# Autodesk Inventor assembly: MM0937AN100_G15_001
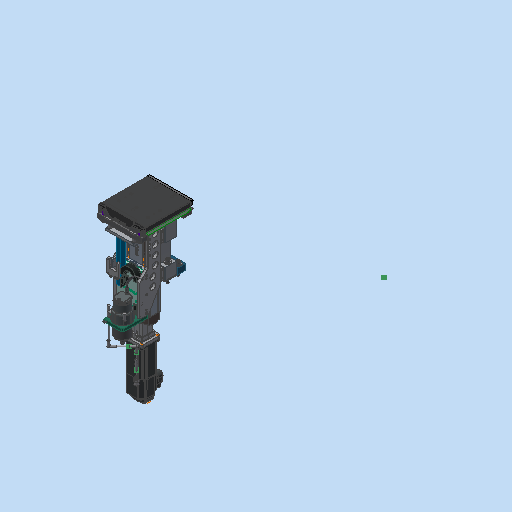
[picture p0: Inventor's stored thumbnail of the model, 512x512]
Saved by Autodesk Inventor 2023.3 (Build 273359000, 359)
## iProperties
RuleStatus: InUse
Created: 2020-12-03
Part Number: MM0937AN100_G15_001
Description: =<RBPARTNOTITLE2>
Document SubType Name: Assembly
Designer: RUD
Mass: 49756.3 g
Surface Area: 14216.7 cm^2
Volume: 7258.05 cm^3
Density: 6.85532 g/cm^3
AnP_Kategorie: 99
AnP_Material: =<Material>
AnP_TemplVers: 20200821
RBDOCUMENTTYPE: DRF
RBDOCUMENTVERSION: 00
RBDRAWINGMAINSCALE: 1:1
RBDRAWINGMISSINGSPEC: --
RBDRAWINGVOLUME: --
RBDSV1: 0850
RBGBEDGESIN1: +0,5
RBGBEDGESIN2: +0,2
RBGBEDGESOUT1: -0,3
RBGBEDGESOUT2: -0,1
RBMATERIAL: =<Material>
RBMATMEETS: --
RBMATNO: =<Part Number>
RBPARTMADEOF: --
RBPARTNO: SIEHE MNR
RBPARTNOTITLE1: Lift-Out Device L207 - short WPC, pitch 5 mm
RBPARTNOTITLE2: Aushubvorrichtung L207 - kurzer WT, 5 mm Steigung
RBPARTSAFETYINDICATOR: --
RBSURFACE: --
RBSURFACE2: --
RBZEDGESNORM: ISO13715:2002-06
RBZGENDIMCLASS: m
RBZGENDIMNORM: ISO 2768-1:1989-11
RBZGENGEOCLASS: H
RBZGENGEONORM: ISO 2768-2:1989-11
RBZSURFACENORM: ISO13D2:2002-02
RBZTOLERANCENORM: ISO 14405-1:2010-12
Author: RUD
Keywords: =<RBPARTMADEOF>
Comments: =<RBSURFACE2>
Revision Number: 01
## Documents named in this file (25)
- C:\Users\rea9an\Documents\Inventor\TCAI2412_te1910_EM\AS00000908.iam
- C:\Users\rea9an\Documents\Inventor\TCAI2412_te1910_EM\PT00004500.ipt
- C:\Users\rea9an\Documents\Inventor\TCAI2412_te1910_EM\PT00004496.ipt
- C:\Users\rea9an\Documents\Inventor\TCAI2412_te1910_EM\PT00004776.ipt
- C:\Users\rea9an\Documents\Inventor\TCAI2412_te1910_EM\PT00004850.ipt
- C:\Users\rea9an\Documents\Inventor\TCAI2412_te1910_EM\AS00000902.iam
- C:\Users\rea9an\Documents\Inventor\TCAI2412_te1910_EM\PT00004830.ipt
- C:\Users\rea9an\Documents\Inventor\TCAI2412_te1910_EM\PT00004887.ipt
- C:\Users\rea9an\Documents\Inventor\TCAI2412_te1910_EM\PT00004498.ipt
- C:\Users\rea9an\Documents\Inventor\TCAI2412_te1910_EM\PT00004849.ipt
- C:\Users\rea9an\Documents\Inventor\TCAI2412_te1910_EM\PT00004501.ipt
- C:\Users\rea9an\Documents\Inventor\TCAI2412_te1910_EM\PT00004447.ipt
- C:\Users\rea9an\Documents\Inventor\TCAI2412_te1910_EM\AS00000903.iam
- C:\Users\rea9an\Documents\Inventor\TCAI2412_te1910_EM\PT00004508.ipt
- C:\Users\rea9an\Documents\Inventor\TCAI2412_te1910_EM\PT00004509.ipt
- C:\Users\rea9an\Documents\Inventor\TCAI2412_te1910_EM\PT00004510.ipt
- C:\Users\rea9an\Documents\Inventor\TCAI2412_te1910_EM\PT00004511.ipt
- C:\Users\rea9an\Documents\Inventor\TCAI2412_te1910_EM\PT00004513.ipt
- C:\Users\rea9an\Documents\Inventor\TCAI2412_te1910_EM\PT00004512.ipt
- C:\Users\rea9an\Documents\Inventor\TCAI2412_te1910_EM\AS00000906.iam
- C:\Users\rea9an\Documents\Inventor\TCAI2412_te1910_EM\AS00000907.iam
- C:\Users\rea9an\Documents\Inventor\TCAI2412_te1910_EM\PT00004495.ipt
- C:\Users\rea9an\Documents\Inventor\TCAI2412_te1910_EM\AS00000909.iam
- C:\Users\rea9an\Documents\Inventor\TCAI2412_te1910_EM\PT00004557.ipt
- C:\Users\rea9an\Documents\Inventor\TCAI2412_te1910_EM\AS00000912.iam
## Components (53 placed, 24 different names)
1. PT00004495:1 — Passend:3, Passend:4, Passend:5, Passend:6, Winkel:2, Winkel:3, Passend:11, Fluchtend:1, Fluchtend:2, Passend:12, Passend:13, Passend:14, Passend:15, Passend:16, Fluchtend:3, Fluchtend:5, Passend:17, Einfügen:28, Einfügen:29, Fluchtend:7, Passend:23, Fluchtend:8, Passend:46, Passend:47, Einfügen:43, Passend:48
2. PT00004496:1 — Passend:11, Fluchtend:1, Fluchtend:2, Fluchtend:4
3. AS00000906:1 [sub-assembly] — Einfügen:42, Passend:44, Passend:45
4. PT00004498:1 — Fluchtend:4, Fluchtend:5, Passend:17, Passend:18, Passend:19, Passend:20, Passend:21, Passend:22, Fluchtend:6
5. PT00004501:1 — Einfügen:28
6. PT00004501:2 — Einfügen:29, Passend:43
7. AS00000902:1 [sub-assembly] — Einfügen:18, Einfügen:19, Einfügen:20, Einfügen:21
8. AS00000907:1 [sub-assembly] — Passend:43, Einfügen:42, Passend:44, Passend:46, Passend:47
9. AS00000909:1 [sub-assembly] — Einfügen:43, Passend:48, Passend:45, Einfügen:44, Passend:49, Einfügen:45, Passend:50
10. PT00004557:1 — Einfügen:44, Passend:49
11. AS00000912:1 [sub-assembly] — Einfügen:45, Passend:50
12. PT00004447:1
13. AS00000903:1 [sub-assembly] — Einfügen:34
14. AS00000903:2 [sub-assembly] — Einfügen:35
15. AS00000903:3 [sub-assembly] — Einfügen:36
16. PT00004508:1
17. PT00004509:1
18. PT00004509:2 — Winkel:9, Winkel:10
19. PT00004509:3 — Einfügen:37, Winkel:8
20. PT00004510:1
21. PT00004510:2 — Einfügen:38
22. PT00004511:1 — Einfügen:37
23. PT00004511:2
24. PT00004511:3
25. PT00004511:4
26. PT00004513:1 — Einfügen:36
27. PT00004512:1 — Winkel:7, Einfügen:38
28. PT00004513:2 — Einfügen:34
29. PT00004512:2 — Einfügen:35
30. PT00004849:1 — Einfügen:27
31. PT00004849:2 — Einfügen:26
32. PT00004850:1 — Einfügen:14
33. PT00004850:2 — Einfügen:15
34. PT00004776:1 — Passend:13, Passend:14, Fluchtend:3, Einfügen:14
35. PT00004776:2 — Passend:12, Passend:15, Passend:16, Einfügen:15
36. PT00004776:3 — Passend:18, Passend:20, Passend:22, Einfügen:26
37. PT00004776:4 — Passend:19, Passend:21, Fluchtend:6, Einfügen:27
38. PT00004830:1 — Einfügen:18
39. PT00004830:2 — Einfügen:19
40. PT00004830:3 — Einfügen:20
41. PT00004830:4 — Einfügen:21
42. PT00004500:1 — Passend:4, Passend:6, Winkel:2, Einfügen:22, Einfügen:23
43. PT00004500:2 — Passend:3, Passend:5, Winkel:3, Einfügen:24, Einfügen:25
44. PT00004887:1 — Einfügen:22
45. PT00004887:2 — Einfügen:23
46. PT00004887:3 — Einfügen:24
47. PT00004887:4 — Einfügen:25
48. PT00004500:3
49. PT00004500:4
50. PT00004887:5
51. PT00004887:6
52. PT00004887:7
53. PT00004887:8
## Component patterns: (2 elements, first: PT00004500:1 + PT00004500:2 + PT00004887:1 + PT00004887:2 + PT00004887:3 + PT00004887:4)
## Relationships (82: Mate 43, Insert 23, Angle 8, Flush 8)
- Passend:3 [Mate]: PT00004495:1 ↔ PT00004500:2
- Passend:4 [Mate]: PT00004495:1 ↔ PT00004500:1
- Passend:5 [Mate]: PT00004495:1 ↔ PT00004500:2
- Passend:6 [Mate]: PT00004495:1 ↔ PT00004500:1
- Winkel:2 [Angle] (0 deg): PT00004495:1 ↔ PT00004500:1
- Winkel:3 [Angle] (0 deg): PT00004495:1 ↔ PT00004500:2
- Passend:11 [Mate] (-0.5 mm): PT00004495:1 ↔ PT00004496:1
- Fluchtend:1 [Flush]: PT00004495:1 ↔ PT00004496:1
- Fluchtend:2 [Flush] (-0.1 mm): PT00004495:1 ↔ PT00004496:1
- Passend:12 [Mate]: PT00004495:1 ↔ PT00004776:2
- Passend:13 [Mate]: PT00004495:1 ↔ PT00004776:1
- Passend:14 [Mate]: PT00004495:1 ↔ PT00004776:1
- Passend:15 [Mate]: PT00004495:1 ↔ PT00004776:2
- Passend:16 [Mate] (-13 mm): PT00004495:1 ↔ PT00004776:2
- Fluchtend:3 [Flush] (-13 mm): PT00004495:1 ↔ PT00004776:1
- Einfügen:14 [Insert]: PT00004850:1 ↔ PT00004776:1
- Einfügen:15 [Insert]: PT00004850:2 ↔ PT00004776:2
- Einfügen:18 [Insert]: AS00000902:1 ↔ PT00004830:1
- Einfügen:19 [Insert]: AS00000902:1 ↔ PT00004830:2
- Einfügen:20 [Insert]: AS00000902:1 ↔ PT00004830:3
- Einfügen:21 [Insert]: AS00000902:1 ↔ PT00004830:4
- Einfügen:22 [Insert]: PT00004500:1 ↔ PT00004887:1
- Einfügen:23 [Insert]: PT00004500:1 ↔ PT00004887:2
- Einfügen:24 [Insert]: PT00004500:2 ↔ PT00004887:3
- Einfügen:25 [Insert]: PT00004500:2 ↔ PT00004887:4
- Fluchtend:4 [Flush]: PT00004496:1 ↔ PT00004498:1
- Fluchtend:5 [Flush]: PT00004495:1 ↔ PT00004498:1
- Passend:17 [Mate]: PT00004495:1 ↔ PT00004498:1
- Passend:18 [Mate]: PT00004498:1 ↔ PT00004776:3
- Passend:19 [Mate]: PT00004498:1 ↔ PT00004776:4
- Passend:20 [Mate]: PT00004498:1 ↔ PT00004776:3
- Passend:21 [Mate]: PT00004498:1 ↔ PT00004776:4
- Passend:22 [Mate] (-13 mm): PT00004498:1 ↔ PT00004776:3
- Fluchtend:6 [Flush] (-13 mm): PT00004498:1 ↔ PT00004776:4
- Einfügen:26 [Insert]: PT00004849:2 ↔ PT00004776:3
- Einfügen:27 [Insert]: PT00004849:1 ↔ PT00004776:4
- Einfügen:28 [Insert]: PT00004495:1 ↔ PT00004501:1
- Einfügen:29 [Insert]: PT00004495:1 ↔ PT00004501:2
- Fluchtend:7 [Flush]: PT00004495:1
- Passend:23 [Mate] (-1267 mm): PT00004495:1
- Fluchtend:8 [Flush] (-787.5 mm): PT00004495:1
- [Mate] (25 mm): PT00004509:1 ↔ PT00004509:3
- [Mate]: PT00004509:3 ↔ PT00004510:1
- [Mate]: PT00004508:1 ↔ PT00004510:1
- [Angle] (180 deg): PT00004509:1 ↔ PT00004509:3
- [Angle] (180 deg): PT00004509:2 ↔ PT00004510:2
- [Mate]: PT00004509:2 ↔ PT00004510:2
- [Mate] (25 mm): PT00004508:1 ↔ PT00004510:1
- [Mate] (25 mm): PT00004509:3 ↔ PT00004510:1
- [Mate]: PT00004509:1 ↔ PT00004509:3
- [Mate] (25 mm): PT00004509:2 ↔ PT00004510:2
- [Mate]: PT00004509:1 ↔ PT00004511:1
- [Mate]: PT00004509:1 ↔ PT00004511:1
- [Mate]: PT00004509:3 ↔ PT00004511:2
- [Mate]: PT00004509:3 ↔ PT00004511:2
- [Mate]: PT00004510:1 ↔ PT00004511:3
- [Mate]: PT00004510:1 ↔ PT00004511:3
- [Mate]: PT00004510:2 ↔ PT00004511:4
- [Mate] (-5 mm): PT00004509:2 ↔ PT00004511:4
- [Mate]: PT00004509:1 ↔ PT00004512:1
- [Mate]: PT00004509:1 ↔ PT00004512:1
- Einfügen:34 [Insert]: AS00000903:1 ↔ PT00004513:2
- Einfügen:35 [Insert]: AS00000903:2 ↔ PT00004512:2
- Einfügen:36 [Insert]: AS00000903:3 ↔ PT00004513:1
- Einfügen:37 [Insert]: PT00004509:3 ↔ PT00004511:1
- Winkel:7 [Angle] (0 deg): PT00004512:1
- Winkel:8 [Angle] (135 deg): PT00004509:3
- Einfügen:38 [Insert]: PT00004510:2 ↔ PT00004512:1
- Winkel:9 [Angle] (180 deg): PT00004509:2
- Winkel:10 [Angle] (180 deg): PT00004509:2
- Passend:43 [Mate]: PT00004501:2 ↔ AS00000907:1
- Einfügen:42 [Insert]: AS00000906:1 ↔ AS00000907:1
- Passend:44 [Mate]: AS00000906:1 ↔ AS00000907:1
- Passend:45 [Mate]: AS00000906:1 ↔ AS00000909:1
- Passend:46 [Mate]: PT00004495:1 ↔ AS00000907:1
- Passend:47 [Mate]: PT00004495:1 ↔ AS00000907:1
- Einfügen:43 [Insert]: PT00004495:1 ↔ AS00000909:1
- Passend:48 [Mate]: PT00004495:1 ↔ AS00000909:1
- Einfügen:44 [Insert]: AS00000909:1 ↔ PT00004557:1
- Passend:49 [Mate]: AS00000909:1 ↔ PT00004557:1
- Einfügen:45 [Insert]: AS00000909:1 ↔ AS00000912:1
- Passend:50 [Mate]: AS00000909:1 ↔ AS00000912:1
